# Autodesk Inventor assembly: MM0948AN002_G60_001
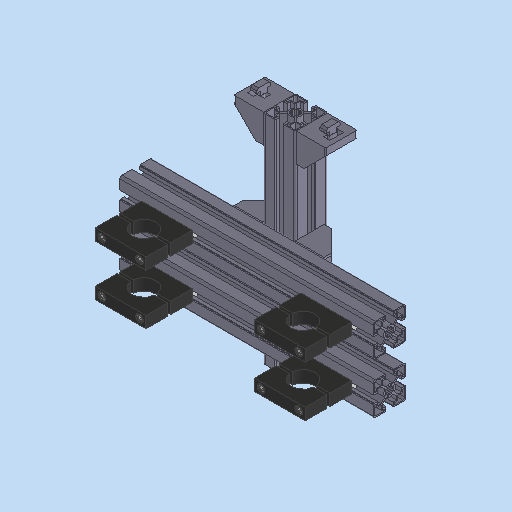
[picture p0: Inventor's stored thumbnail of the model, 512x512]
Saved by Autodesk Inventor 2023.3 (Build 273359000, 359)
## iProperties
RuleStatus: InUse
Created: 2022-12-08
Part Number: MM0948AN002_G60_001
Description: =<RBPARTNOTITLE2>
Document SubType Name: Assembly
Designer: ric7an
Mass: 2670.73 g
Surface Area: 8008.89 cm^2
Volume: 1003.29 cm^3
Density: 2.66198 g/cm^3
AnP_Kategorie: 99
AnP_Material: =<Material>
AnP_TemplVers: 20200821
RBDOCUMENTTYPE: DRF
RBDOCUMENTVERSION: 00
RBDRAWINGMAINSCALE: 1:1
RBDRAWINGMISSINGSPEC: --
RBDRAWINGVOLUME: --
RBDSV1: 0850
RBGBEDGESIN1: +0,5
RBGBEDGESIN2: +0,2
RBGBEDGESOUT1: -0,3
RBGBEDGESOUT2: -0,1
RBMATERIAL: =<Material>
RBMATMEETS: --
RBMATNO: =<Part Number>
RBPARTMADEOF: --
RBPARTNO: SIEHE MNR
RBPARTNOTITLE1: ball valvel holder LT4
RBPARTNOTITLE2: Kugelhahnhalter LT4
RBPARTSAFETYINDICATOR: --
RBSURFACE: --
RBSURFACE2: --
RBZEDGESNORM: ISO13715:2002-06
RBZGENDIMCLASS: m
RBZGENDIMNORM: ISO 2768-1:1989-11
RBZGENGEOCLASS: H
RBZGENGEONORM: ISO 2768-2:1989-11
RBZSURFACENORM: ISO13D2:2002-02
RBZTOLERANCENORM: ISO 14405-1:2010-12
Author: ric7an
Keywords: =<RBPARTMADEOF>
Comments: =<RBSURFACE2>
Revision Number: 01
## Documents named in this file (8)
- C:\Users\rea9an\Documents\Inventor\TCAI2412_te1910_EM\AS00000932.iam
- C:\Users\rea9an\Documents\Inventor\TCAI2412_te1910_EM\PT00004300.ipt
- C:\Users\rea9an\Documents\Inventor\TCAI2412_te1910_EM\PT00004335.ipt
- C:\Users\rea9an\Documents\Inventor\TCAI2412_te1910_EM\PT00004336.ipt
- C:\Users\rea9an\Documents\Inventor\TCAI2412_te1910_EM\PT00004572.ipt
- C:\Users\rea9an\Documents\Inventor\TCAI2412_te1910_EM\PT00004573.ipt
- C:\Users\rea9an\Documents\Inventor\TCAI2412_te1910_EM\PT00004893.ipt
- C:\Users\rea9an\Documents\Inventor\TCAI2412_te1910_EM\PT00004309.ipt
## Components (33 placed, 7 different names)
1. PT00004572:1 — Einfügen:1, Einfügen:2
2. PT00004573:1 — Fluchtend:15, Fluchtend:17, Fluchtend:24, Einfügen:14, Einfügen:16
3. PT00004572:2 — Einfügen:5, Einfügen:7
4. PT00004573:2 — Fluchtend:15, Fluchtend:17, Einfügen:11, Einfügen:12
5. PT00004572:3 — Einfügen:3, Einfügen:4
6. PT00004573:3 — Passend:19, Fluchtend:24, Fluchtend:25, Einfügen:13, Einfügen:15
7. PT00004572:4 — Einfügen:6, Einfügen:8
8. PT00004573:4 — Passend:20, Einfügen:9, Einfügen:10
9. PT00004309:1 — Einfügen:13, Fluchtend:33
10. PT00004309:2 — Einfügen:16, Fluchtend:32
11. PT00004309:6 — Einfügen:15, Fluchtend:33
12. PT00004309:7 — Einfügen:11, Fluchtend:31
13. PT00004309:8 — Einfügen:9, Fluchtend:30
14. PT00004309:9 — Einfügen:10, Fluchtend:30
15. PT00004309:10 — Einfügen:12, Fluchtend:31
16. PT00004309:11 — Einfügen:14, Fluchtend:32
17. PT00004893:1 — Einfügen:1
18. PT00004893:2 — Einfügen:2
19. PT00004893:3 — Einfügen:4
20. PT00004893:4 — Einfügen:3
21. PT00004893:5 — Einfügen:5
22. PT00004893:6 — Einfügen:6
23. PT00004893:7 — Einfügen:8
24. PT00004893:8 — Einfügen:7
25. PT00004300:8 — Passend:25, Passend:26, Fluchtend:28
26. PT00004300:7 — Passend:27, Passend:28, Fluchtend:29
27. PT00004300:6 — Passend:23, Passend:24, Fluchtend:26
28. PT00004300:5 — Passend:21, Passend:22, Fluchtend:27
29. PT00004335:2 — Fluchtend:19, Passend:15, Passend:16, Passend:19, Passend:20, Fluchtend:25, Passend:21, Passend:23, Fluchtend:26, Fluchtend:27
30. PT00004336:1 — Fluchtend:18, Passend:16, Passend:22, Passend:24, Passend:26, Passend:28
31. PT00004300:1
32. PT00004300:2
33. PT00004335:1 — Fluchtend:18, Fluchtend:19, Passend:15, Passend:25, Passend:27, Fluchtend:28, Fluchtend:29
## Relationships (68: Flush 26, Mate 22, Insert 16, Angle 4)
- [Mate]: PT00004336:1 ↔ PT00004300:1
- [Flush]: PT00004336:1 ↔ PT00004300:1
- [Mate]: PT00004336:1 ↔ PT00004300:2
- [Flush]: PT00004336:1 ↔ PT00004300:2
- [Flush] (1 mm): PT00004336:1 ↔ PT00004300:2
- [Flush] (1 mm): PT00004336:1 ↔ PT00004300:1
- [Flush] (-175 mm): PT00004336:1 ↔ PT00004335:1
- [Mate]: PT00004572:1 ↔ PT00004573:1
- [Flush]: PT00004572:1 ↔ PT00004573:1
- [Angle] (180 deg): PT00004572:1 ↔ PT00004573:1
- [Mate]: PT00004572:2 ↔ PT00004573:2
- [Flush]: PT00004572:2 ↔ PT00004573:2
- [Angle] (180 deg): PT00004572:2 ↔ PT00004573:2
- [Mate]: PT00004573:1 ↔ PT00004335:1
- [Mate]: PT00004573:2 ↔ PT00004335:1
- [Mate]: PT00004573:1 ↔ PT00004335:1
- Fluchtend:15 [Flush] (220 mm): PT00004573:1 ↔ PT00004573:2
- [Flush] (-110 mm): PT00004573:1 ↔ PT00004336:1
- Fluchtend:17 [Flush]: PT00004573:1 ↔ PT00004573:2
- [Mate]: PT00004336:1 ↔ PT00004335:1
- Fluchtend:18 [Flush] (-200 mm): PT00004336:1 ↔ PT00004335:1
- Fluchtend:19 [Flush]: PT00004335:2 ↔ PT00004335:1
- Passend:15 [Mate] (-70 mm): PT00004335:2 ↔ PT00004335:1
- Passend:16 [Mate]: PT00004335:2 ↔ PT00004336:1
- [Mate]: PT00004572:3 ↔ PT00004573:3
- [Flush]: PT00004572:3 ↔ PT00004573:3
- [Angle] (180 deg): PT00004572:3 ↔ PT00004573:3
- [Mate]: PT00004572:4 ↔ PT00004573:4
- [Flush]: PT00004572:4 ↔ PT00004573:4
- [Angle] (180 deg): PT00004572:4 ↔ PT00004573:4
- [Flush] (220 mm): PT00004573:3 ↔ PT00004573:4
- [Flush]: PT00004573:3 ↔ PT00004573:4
- Passend:19 [Mate]: PT00004573:3 ↔ PT00004335:2
- Passend:20 [Mate]: PT00004573:4 ↔ PT00004335:2
- Fluchtend:24 [Flush]: PT00004573:1 ↔ PT00004573:3
- Fluchtend:25 [Flush]: PT00004573:3 ↔ PT00004335:2
- Passend:21 [Mate]: PT00004300:5 ↔ PT00004335:2
- Passend:22 [Mate]: PT00004300:5 ↔ PT00004336:1
- Passend:23 [Mate]: PT00004300:6 ↔ PT00004335:2
- Passend:24 [Mate]: PT00004300:6 ↔ PT00004336:1
- Passend:25 [Mate]: PT00004300:8 ↔ PT00004335:1
- Passend:26 [Mate]: PT00004300:8 ↔ PT00004336:1
- Passend:27 [Mate]: PT00004300:7 ↔ PT00004335:1
- Passend:28 [Mate]: PT00004300:7 ↔ PT00004336:1
- Fluchtend:26 [Flush] (1 mm): PT00004300:6 ↔ PT00004335:2
- Fluchtend:27 [Flush] (1 mm): PT00004300:5 ↔ PT00004335:2
- Fluchtend:28 [Flush] (1 mm): PT00004300:8 ↔ PT00004335:1
- Fluchtend:29 [Flush] (1 mm): PT00004300:7 ↔ PT00004335:1
- Einfügen:1 [Insert]: PT00004572:1 ↔ PT00004893:1
- Einfügen:2 [Insert]: PT00004572:1 ↔ PT00004893:2
- Einfügen:3 [Insert]: PT00004572:3 ↔ PT00004893:4
- Einfügen:4 [Insert]: PT00004572:3 ↔ PT00004893:3
- Einfügen:5 [Insert]: PT00004572:2 ↔ PT00004893:5
- Einfügen:6 [Insert]: PT00004572:4 ↔ PT00004893:6
- Einfügen:7 [Insert]: PT00004572:2 ↔ PT00004893:8
- Einfügen:8 [Insert]: PT00004572:4 ↔ PT00004893:7
- Einfügen:9 [Insert] (3.8 mm): PT00004573:4 ↔ PT00004309:8
- Einfügen:10 [Insert] (3.8 mm): PT00004573:4 ↔ PT00004309:9
- Einfügen:11 [Insert] (3.8 mm): PT00004573:2 ↔ PT00004309:7
- Einfügen:12 [Insert] (3.8 mm): PT00004573:2 ↔ PT00004309:10
- Einfügen:13 [Insert] (3.8 mm): PT00004573:3 ↔ PT00004309:1
- Einfügen:14 [Insert] (3.8 mm): PT00004573:1 ↔ PT00004309:11
- Einfügen:15 [Insert] (3.8 mm): PT00004573:3 ↔ PT00004309:6
- Einfügen:16 [Insert] (3.8 mm): PT00004573:1 ↔ PT00004309:2
- Fluchtend:30 [Flush]: PT00004309:8 ↔ PT00004309:9
- Fluchtend:31 [Flush]: PT00004309:7 ↔ PT00004309:10
- Fluchtend:32 [Flush]: PT00004309:2 ↔ PT00004309:11
- Fluchtend:33 [Flush]: PT00004309:1 ↔ PT00004309:6
## Named parameters: d303_d281 = 0 mm, d304_d282 = 0 mm, d305_d283 = 180 deg, d316_d294_d281 = 0 mm, d317_d295_d282 = 0 mm, d318_d296_d283 = 180 deg, d42_d303_d281 = 0 mm, d43_d304_d282 = 0 mm, d44_d305_d283 = 180 deg, d45_d316_d294_d281 = 0 mm, d46_d317_d295_d282 = 0 mm, d47_d318_d296_d283 = 180 deg, d48_d33 = 220 mm, d49_d36 = 0 mm
